# Autodesk Inventor assembly: MM0948AN110_G10_001
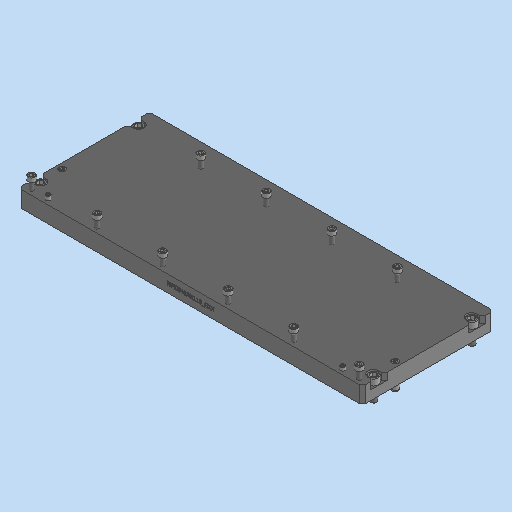
[picture p0: Inventor's stored thumbnail of the model, 512x512]
Saved by Autodesk Inventor 2023.3 (Build 273359000, 359)
## iProperties
RuleStatus: InUse
Created: 2023-03-23
Part Number: MM0948AN110_G10_001
Description: =<RBPARTNOTITLE2>
Document SubType Name: Assembly
Designer: FH/Wi
Mass: 35642.6 g
Surface Area: 3946.98 cm^2
Volume: 4540.46 cm^3
Density: 7.85 g/cm^3
AnP_Kategorie: 99
AnP_Material: =<Material>
AnP_TemplVers: 20200821
RBDOCUMENTTYPE: DRF
RBDOCUMENTVERSION: 00
RBDRAWINGMAINSCALE: 1:1
RBDRAWINGMISSINGSPEC: --
RBDRAWINGVOLUME: --
RBDSV1: 0850
RBGBEDGESIN1: +0,5
RBGBEDGESIN2: +0,2
RBGBEDGESOUT1: -0,3
RBGBEDGESOUT2: -0,1
RBMATERIAL: =<Material>
RBMATMEETS: --
RBMATNO: =<Part Number>
RBPARTMADEOF: --
RBPARTNO: SIEHE MNR
RBPARTNOTITLE1: Base plate axis system
RBPARTNOTITLE2: Grundplatte Achssystem
RBPARTSAFETYINDICATOR: --
RBSURFACE: --
RBSURFACE2: --
RBZEDGESNORM: ISO13715:2002-06
RBZGENDIMCLASS: m
RBZGENDIMNORM: ISO 2768-1:1989-11
RBZGENGEOCLASS: H
RBZGENGEONORM: ISO 2768-2:1989-11
RBZSURFACENORM: ISO13D2:2002-02
RBZTOLERANCENORM: ISO 14405-1:2010-12
Author: FH/Wi
Keywords: =<RBPARTMADEOF>
Comments: =<RBSURFACE2>
Revision Number: 01
## Documents named in this file (6)
- C:\Users\rea9an\Documents\Inventor\TCAI2412_te1910_EM\AS00000943.iam
- C:\Users\rea9an\Documents\Inventor\TCAI2412_te1910_EM\PT00004854.ipt
- C:\Users\rea9an\Documents\Inventor\TCAI2412_te1910_EM\PT00004899.ipt
- C:\Users\rea9an\Documents\Inventor\TCAI2412_te1910_EM\PT00004896.ipt
- C:\Users\rea9an\Documents\Inventor\TCAI2412_te1910_EM\PT00004630.ipt
- C:\Users\rea9an\Documents\Inventor\TCAI2412_te1910_EM\PT00004910.ipt
## Components (19 placed, 5 different names)
1. PT00004630:1 — Einfügen:7, Einfügen:8, Einfügen:9, Einfügen:10, Einfügen:11, Einfügen:12, Einfügen:13, Einfügen:14, Einfügen:17, Einfügen:18, Einfügen:19, Einfügen:20
2. PT00004896:10 — Einfügen:17
3. PT00004896:11 — Einfügen:18
4. PT00004910:1 — Einfügen:19
5. PT00004910:2 — Einfügen:20
6. PT00004854:1
7. PT00004854:2
8. PT00004854:3
9. PT00004854:4
10. PT00004899:1
11. PT00004899:2
12. PT00004896:1 — Einfügen:9
13. PT00004896:2 — Einfügen:13
14. PT00004896:3 — Einfügen:10
15. PT00004896:4 — Einfügen:12
16. PT00004896:6 — Einfügen:11
17. PT00004896:7 — Einfügen:8
18. PT00004896:8 — Einfügen:7
19. PT00004896:9 — Einfügen:14
## Relationships (18: Insert 18)
- [Insert]: PT00004630:1 ↔ PT00004854:1
- [Insert]: PT00004630:1 ↔ PT00004854:2
- [Insert]: PT00004630:1 ↔ PT00004854:3
- [Insert]: PT00004630:1 ↔ PT00004854:4
- [Insert]: PT00004630:1 ↔ PT00004899:2
- [Insert]: PT00004630:1 ↔ PT00004899:1
- Einfügen:7 [Insert] (15.9 mm): PT00004630:1 ↔ PT00004896:8
- Einfügen:8 [Insert] (15.9 mm): PT00004630:1 ↔ PT00004896:7
- Einfügen:9 [Insert] (15.9 mm): PT00004630:1 ↔ PT00004896:1
- Einfügen:10 [Insert] (15.9 mm): PT00004630:1 ↔ PT00004896:3
- Einfügen:11 [Insert] (15.9 mm): PT00004630:1 ↔ PT00004896:6
- Einfügen:12 [Insert] (15.9 mm): PT00004630:1 ↔ PT00004896:4
- Einfügen:13 [Insert] (15.9 mm): PT00004630:1 ↔ PT00004896:2
- Einfügen:14 [Insert] (15.9 mm): PT00004630:1 ↔ PT00004896:9
- Einfügen:17 [Insert] (15.9 mm): PT00004630:1 ↔ PT00004896:10
- Einfügen:18 [Insert] (15.9 mm): PT00004630:1 ↔ PT00004896:11
- Einfügen:19 [Insert]: PT00004630:1 ↔ PT00004910:1
- Einfügen:20 [Insert]: PT00004630:1 ↔ PT00004910:2
